# Autodesk Inventor assembly: XT=upper
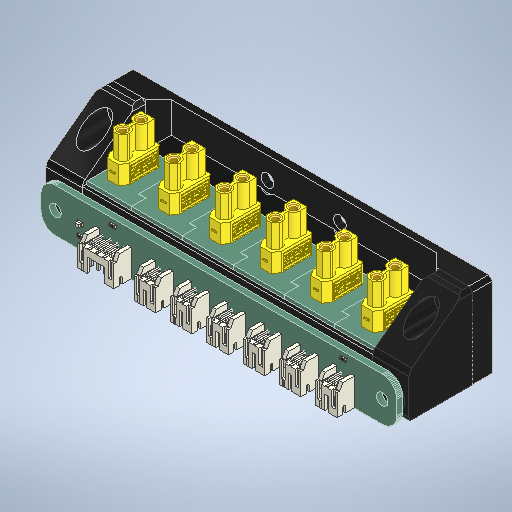
[picture p0: Inventor's stored thumbnail of the model, 512x512]
Saved by Autodesk Inventor 2025.3 (Build 293356030, 356C)
## iProperties
Created: 2025-09-08
Part Number: XT=upper
Document SubType Name: Assembly
Designer: ibuki_ono
Author: ibuki_ono
## Documents named in this file (6)
- C:\Users\ibuki_ono\Documents\hobby\rogiken\catchrobo\CAD\Hardware_CAD\Inventor\circuit\XT=upper.iam
- C:\Users\ibuki_ono\Documents\hobby\rogiken\catchrobo\CAD\Hardware_CAD\Inventor\circuit\CAN-hub\CAN-hub\CAN-hub.iam
- C:\Users\ibuki_ono\Documents\hobby\rogiken\catchrobo\CAD\Hardware_CAD\Inventor\circuit\3D_XT30-fix2.ipt
- C:\Users\ibuki_ono\Documents\hobby\rogiken\catchrobo\CAD\Hardware_CAD\Inventor\circuit\3D_XT30-fix3.ipt
- C:\Users\ibuki_ono\Documents\hobby\rogiken\catchrobo\CAD\Hardware_CAD\Inventor\circuit\XT30-hub\XT30-hub\XT30-6.iam
- C:\Users\ibuki_ono\Documents\hobby\rogiken\catchrobo\CAD\Hardware_CAD\Inventor\circuit\3D_XT30-fix3-mir.ipt
## Components (5 placed, 5 different names)
1. CAN-hub:1 [sub-assembly] — 挿入:3, 挿入:6
2. 3D_XT30-fix2:1 — 挿入:1, 挿入:2, メイト:1, メイト:2, 挿入:4, 挿入:5
3. 3D_XT30-fix3:1 — 挿入:1, 挿入:2, メイト:3, 挿入:3
4. XT30-6:1 [sub-assembly] — メイト:1, メイト:2, メイト:3
5. 3D_XT30-fix3-mir:1 — 挿入:4, 挿入:5, 挿入:6
## Relationships (9: Insert 6, Mate 3)
- 挿入:1 [Insert]: 3D_XT30-fix2:1 ↔ 3D_XT30-fix3:1
- 挿入:2 [Insert]: 3D_XT30-fix2:1 ↔ 3D_XT30-fix3:1
- メイト:1 [Mate]: 3D_XT30-fix2:1 ↔ XT30-6:1
- メイト:2 [Mate]: 3D_XT30-fix2:1 ↔ XT30-6:1
- メイト:3 [Mate] (0.1 mm): 3D_XT30-fix3:1 ↔ XT30-6:1
- 挿入:3 [Insert]: CAN-hub:1 ↔ 3D_XT30-fix3:1
- 挿入:4 [Insert]: 3D_XT30-fix2:1 ↔ 3D_XT30-fix3-mir:1
- 挿入:5 [Insert]: 3D_XT30-fix2:1 ↔ 3D_XT30-fix3-mir:1
- 挿入:6 [Insert]: CAN-hub:1 ↔ 3D_XT30-fix3-mir:1
